# Autodesk Inventor assembly: dtmotorsub
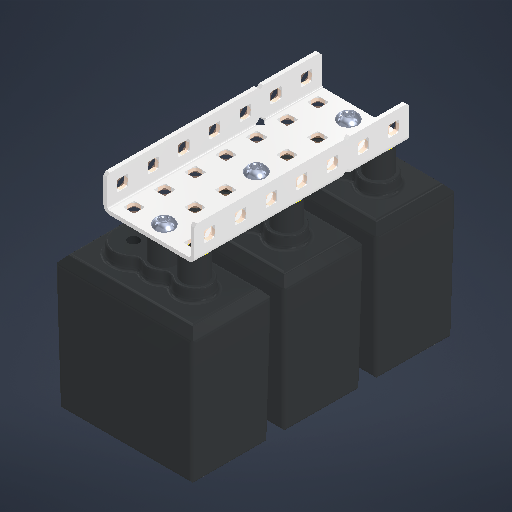
[picture p0: Inventor's stored thumbnail of the model, 512x512]
Saved by Autodesk Inventor 2026.2 (Build 302298000, 298)
## iProperties
Created: 2026-11-04
Part Number: dtmotorsub
Document SubType Name: Assembly
Designer: BuddyProject
Author: BuddyProject
## Documents named in this file (5)
- E:\593C-CAD-26-27\dtmotorsub.iam
- E:\VEX-CAD-Inventor-main\Structure\C Channel\Aluminum 1x3x1\Alu C 1x3x1x7.ipt
- E:\VEX-CAD-Inventor-main\Structure\Hardware\Screw Steel - Star\SScrew Star Smooth .250.ipt
- E:\VEX-CAD-Inventor-main\Structure\Hardware\Screw Steel - Star.ipt
- E:\593C-CAD-26-27\ModifiedComponents\V5 Simple Motor.ipt
## Components (7 placed, 3 different names)
1. Alu C 1x3x1x7:1
2. V5 Simple Motor:4
3. V5 Simple Motor:5
4. V5 Simple Motor:6
5. SScrew Star Smooth .250:1
6. SScrew Star Smooth .250:2
7. SScrew Star Smooth .250:3
## Relationships (12: Mate 12)
- [Mate]: Alu C 1x3x1x7:1 ↔ V5 Simple Motor:5
- [Mate]: Alu C 1x3x1x7:1 ↔ V5 Simple Motor:5
- [Mate]: Alu C 1x3x1x7:1 ↔ V5 Simple Motor:6
- [Mate]: Alu C 1x3x1x7:1 ↔ V5 Simple Motor:6
- [Mate]: Alu C 1x3x1x7:1 ↔ V5 Simple Motor:4
- [Mate]: Alu C 1x3x1x7:1 ↔ V5 Simple Motor:4
- [Mate]: Alu C 1x3x1x7:1 ↔ SScrew Star Smooth .250:3
- [Mate]: Alu C 1x3x1x7:1 ↔ SScrew Star Smooth .250:3
- [Mate]: Alu C 1x3x1x7:1 ↔ SScrew Star Smooth .250:2
- [Mate]: Alu C 1x3x1x7:1 ↔ SScrew Star Smooth .250:2
- [Mate]: Alu C 1x3x1x7:1 ↔ SScrew Star Smooth .250:1
- [Mate]: Alu C 1x3x1x7:1 ↔ SScrew Star Smooth .250:1
